# Autodesk Inventor assembly: MM0948AN160_G15_001
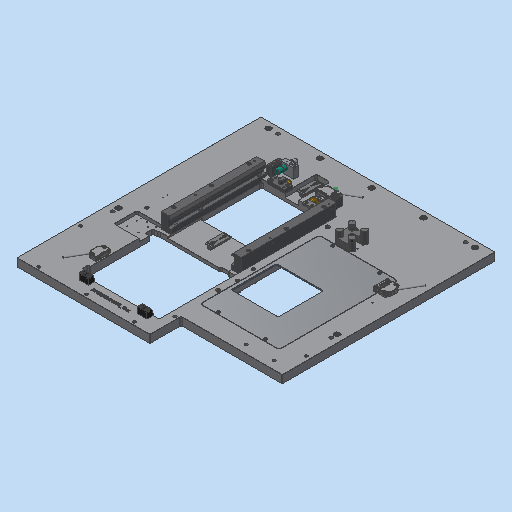
[picture p0: Inventor's stored thumbnail of the model, 512x512]
Saved by Autodesk Inventor 2023.3 (Build 273359000, 359)
## iProperties
Part Number: MM0948AN160_G15_001
Material: Generisch
Description: =<RBPARTNOTITLE2>
Document SubType Name: Assembly
Designer: FH/Wi
Mass: 74112.6 g
Surface Area: 13767 cm^2
Volume: 10091.6 cm^3
Density: 7.34398 g/cm^3
Created: 2023-03-23
RBCHANGEDESCRIPTION1: Erstfreigabe
RBCHANGENO1: 00
RBDOCUMENTTYPE: DRF
RBDOCUMENTVERSION: 00
RBDRAWINGMAINSCALE: 1:1
RBDRAWINGMISSINGSPEC: --
RBDRAWINGVOLUME: --
RBDSV1: 0850
RBGBDETAILS: 43274
RBGBEDGESIN1: +0,5
RBGBEDGESIN2: +0,2
RBGBEDGESOUT1: -0,3
RBGBEDGESOUT2: -0,1
RBMATERIAL: =<Material>
RBMATMEETS: --
RBMATNO: =<Part Number>
RBORGUNITRESPONSIBLE1: AnP/TEF1
RBPARTMADEOF: --
RBPARTNO: SIEHE MNR
RBPARTNOTITLE1: process plate CIPG
RBPARTNOTITLE2: Prozessplatte CIPG
RBPARTSAFETYINDICATOR: --
RBSURFACE: --
RBSURFACE2: --
RBZEDGESNORM: ISO13715:2002-06
RBZGENDIMCLASS: m
RBZGENDIMNORM: ISO 2768-1:1989-11
RBZGENGEOCLASS: H
RBZGENGEONORM: ISO 2768-2:1989-11
RBZSURFACENORM: ISO13D2:2002-02
RBZTOLERANCENORM: ISO 14405-1:2010-12
AnP_Kommentar: --
MaxAbmaße: --
AnP_TemplVers: 20190222
AnP_Kategorie: 99
AnP_Material: =<Material>
Author: FH/Wi
Keywords: =<RBPARTMADEOF>
Comments: =<RBSURFACE2>
Revision Number: 01
## Documents named in this file (51)
- C:\Users\rea9an\Documents\Inventor\TCAI2412_te1910_EM\AS00000961.iam
- C:\Users\rea9an\Documents\Inventor\TCAI2412_te1910_EM\PT00004403.ipt
- C:\Users\rea9an\Documents\Inventor\TCAI2412_te1910_EM\PT00004874.ipt
- C:\Users\rea9an\Documents\Inventor\TCAI2412_te1910_EM\PT00004872.ipt
- C:\Users\rea9an\Documents\Inventor\TCAI2412_te1910_EM\PT00004525.ipt
- C:\Users\rea9an\Documents\Inventor\TCAI2412_te1910_EM\PT00004526.ipt
- C:\Users\rea9an\Documents\Inventor\TCAI2412_te1910_EM\PT00004921.ipt
- C:\Users\rea9an\Documents\Inventor\TCAI2412_te1910_EM\PT00004871.ipt
- C:\Users\rea9an\Documents\Inventor\TCAI2412_te1910_EM\PT00004847.ipt
- C:\Users\rea9an\Documents\Inventor\TCAI2412_te1910_EM\PT00004900.ipt
- C:\Users\rea9an\Documents\Inventor\TCAI2412_te1910_EM\PT00004878.ipt
- C:\Users\rea9an\Documents\Inventor\TCAI2412_te1910_EM\PT00004778.ipt
- C:\Users\rea9an\Documents\Inventor\TCAI2412_te1910_EM\PT00004395.ipt
- C:\Users\rea9an\Documents\Inventor\TCAI2412_te1910_EM\PT00004876.ipt
- C:\Users\rea9an\Documents\Inventor\TCAI2412_te1910_EM\PT00004687.ipt
- C:\Users\rea9an\Documents\Inventor\TCAI2412_te1910_EM\PT00004692.ipt
- C:\Users\rea9an\Documents\Inventor\TCAI2412_te1910_EM\PT00004688.ipt
- C:\Users\rea9an\Documents\Inventor\TCAI2412_te1910_EM\PT00004883.ipt
- C:\Users\rea9an\Documents\Inventor\TCAI2412_te1910_EM\PT00004693.ipt
- C:\Users\rea9an\Documents\Inventor\TCAI2412_te1910_EM\PT00004869.ipt
- C:\Users\rea9an\Documents\Inventor\TCAI2412_te1910_EM\PT00004695.ipt
- C:\Users\rea9an\Documents\Inventor\TCAI2412_te1910_EM\PT00004689.ipt
- C:\Users\rea9an\Documents\Inventor\TCAI2412_te1910_EM\PT00004694.ipt
- C:\Users\rea9an\Documents\Inventor\TCAI2412_te1910_EM\PT00004691.ipt
- C:\Users\rea9an\Documents\Inventor\TCAI2412_te1910_EM\PT00004873.ipt
- C:\Users\rea9an\Documents\Inventor\TCAI2412_te1910_EM\PT00004690.ipt
- C:\Users\rea9an\Documents\Inventor\TCAI2412_te1910_EM\PT00004918.ipt
- C:\Users\rea9an\Documents\Inventor\TCAI2412_te1910_EM\PT00004846.ipt
- C:\Users\rea9an\Documents\Inventor\TCAI2412_te1910_EM\PT00004882.ipt
- C:\Users\rea9an\Documents\Inventor\TCAI2412_te1910_EM\PT00004889.ipt
- C:\Users\rea9an\Documents\Inventor\TCAI2412_te1910_EM\PT00004296.ipt
- C:\Users\rea9an\Documents\Inventor\TCAI2412_te1910_EM\PT00004315.ipt
- C:\Users\rea9an\Documents\Inventor\TCAI2412_te1910_EM\PT00004304.ipt
- C:\Users\rea9an\Documents\Inventor\TCAI2412_te1910_EM\PT00004696.ipt
- C:\Users\rea9an\Documents\Inventor\TCAI2412_te1910_EM\PT00004906.ipt
- C:\Users\rea9an\Documents\Inventor\TCAI2412_te1910_EM\PT00004908.ipt
- C:\Users\rea9an\Documents\Inventor\TCAI2412_te1910_EM\PT00004393.ipt
- C:\Users\rea9an\Documents\Inventor\TCAI2412_te1910_EM\PT00004907.ipt
- C:\Users\rea9an\Documents\Inventor\TCAI2412_te1910_EM\PT00004788.ipt
- C:\Users\rea9an\Documents\Inventor\TCAI2412_te1910_EM\PT00004398.ipt
- C:\Users\rea9an\Documents\Inventor\TCAI2412_te1910_EM\PT00004867.ipt
- C:\Users\rea9an\Documents\Inventor\TCAI2412_te1910_EM\PT00004400.ipt
- C:\Users\rea9an\Documents\Inventor\TCAI2412_te1910_EM\PT00004697.ipt
- C:\Users\rea9an\Documents\Inventor\TCAI2412_te1910_EM\PT00004830.ipt
- C:\Users\rea9an\Documents\Inventor\TCAI2412_te1910_EM\PT00004866.ipt
- C:\Users\rea9an\Documents\Inventor\TCAI2412_te1910_EM\PT00004915.ipt
- C:\Users\rea9an\Documents\Inventor\TCAI2412_te1910_EM\PT00004698.ipt
- C:\Users\rea9an\Documents\Inventor\TCAI2412_te1910_EM\PT00004699.ipt
- C:\Users\rea9an\Documents\Inventor\TCAI2412_te1910_EM\PT00004700.ipt
- C:\Users\rea9an\Documents\Inventor\TCAI2412_te1910_EM\PT00004892.ipt
- C:\Users\rea9an\Documents\Inventor\TCAI2412_te1910_EM\PT00004493.ipt
## Components (148 placed, 50 different names)
1. PT00004698:1 — Fluchtend:4, Fluchtend:5, Passend:18, Passend:19, Passend:20, Passend:22, Einfügen:29, Einfügen:30, Einfügen:36, Einfügen:37, Einfügen:76, Einfügen:77, Einfügen:78, Einfügen:79, Einfügen:80, Einfügen:81, Einfügen:84, Einfügen:86, Einfügen:93, Einfügen:94, Einfügen:95, Einfügen:96, Einfügen:97, Einfügen:98, Einfügen:99, Einfügen:100, Einfügen:101, Einfügen:102, Einfügen:103, Passend:54, Passend:56, Passend:57, Passend:58, Einfügen:109, Passend:60, Fluchtend:20, Passend:63, Passend:64, Passend:66, Passend:67, Passend:68, Passend:69, Passend:70, Passend:71, Passend:72, Passend:73, Passend:74, Passend:111, Fluchtend:21, Einfügen:122, Einfügen:123, Passend:115, Einfügen:136, Einfügen:137, Passend:121, Einfügen:153, Einfügen:154, Einfügen:155, Einfügen:156, Einfügen:157, Einfügen:158, Einfügen:159, Einfügen:160, Einfügen:161, Einfügen:162, Einfügen:163, Einfügen:164, Einfügen:165, Einfügen:166, Einfügen:167, Einfügen:179, Einfügen:180, Einfügen:194, Einfügen:195, Einfügen:197, Winkel:1, Einfügen:198, Einfügen:199, Einfügen:200, Passend:137, Passend:138, Einfügen:203, Einfügen:204, Passend:143, Fluchtend:45, Passend:146, Einfügen:207, Einfügen:208, Einfügen:209, Einfügen:210
2. PT00004687:1 — Passend:115, Einfügen:136, Einfügen:137, Passend:144, Fluchtend:46, Passend:145
3. PT00004699:1 — Fluchtend:3, Fluchtend:4, Passend:18, Passend:44, Passend:45, Fluchtend:12, Fluchtend:13, Einfügen:183, Einfügen:184, Einfügen:185, Einfügen:186, Einfügen:203
4. PT00004700:1 — Fluchtend:3, Fluchtend:5, Passend:19, Passend:36, Passend:43, Fluchtend:14, Fluchtend:15, Einfügen:187, Einfügen:188, Einfügen:189, Einfügen:190
5. PT00004688:1 — Passend:20, Einfügen:81, Fluchtend:23
6. PT00004688:2 — Passend:22, Einfügen:80, Fluchtend:22
7. PT00004689:2 — Einfügen:29, Einfügen:30
8. PT00004690:1 — Passend:121, Fluchtend:27, Fluchtend:29, Fluchtend:30, Einfügen:145, Einfügen:146, Einfügen:149, Einfügen:150, Einfügen:153
9. PT00004690:2 — Fluchtend:29, Fluchtend:30, Einfügen:143, Einfügen:144, Einfügen:147, Einfügen:148, Einfügen:204
10. PT00004691:1 — Passend:36, Fluchtend:14
11. PT00004691:2 — Passend:43, Fluchtend:15
12. PT00004691:3 — Passend:44, Fluchtend:13
13. PT00004691:4 — Passend:45, Fluchtend:12
14. PT00004692:1 — Passend:54, Passend:56, Passend:57, Einfügen:107, Einfügen:108, Passend:116, Passend:117, Passend:151, Passend:152, Fluchtend:54, Passend:155
15. PT00004693:1 — Passend:58, Passend:59, Einfügen:109, Passend:60
16. PT00004694:1 — Einfügen:36, Passend:124
17. PT00004694:2 — Einfügen:37, Passend:124
18. PT00004695:1 — Fluchtend:20, Passend:63, Passend:64, Passend:95, Passend:96
19. PT00004695:2 — Passend:66, Passend:67, Passend:68, Passend:103, Passend:104
20. PT00004695:3 — Passend:69, Passend:73, Passend:74, Passend:93, Passend:94
21. PT00004695:4 — Passend:70, Passend:71, Passend:72, Passend:105, Passend:106
22. PT00004696:1 — Einfügen:194, Einfügen:195
23. PT00004788:1 — Einfügen:201, Einfügen:202, Passend:137, Passend:138
24. PT00004907:1 — Einfügen:199
25. PT00004907:2 — Einfügen:200
26. PT00004907:3 — Einfügen:198
27. PT00004871:15 — Einfügen:202
28. PT00004871:16 — Einfügen:201
29. PT00004395:4 — Passend:143, Fluchtend:45, Passend:146, Passend:147, Passend:148, Passend:149, Passend:150
30. PT00004398:2 — Passend:144, Fluchtend:46, Passend:145, Einfügen:205, Einfügen:206
31. PT00004867:1 — Passend:148, Passend:149
32. PT00004867:2 — Passend:147, Passend:150
33. PT00004867:3 — Einfügen:206
34. PT00004867:4 — Einfügen:205
35. PT00004697:1 — Passend:151, Passend:152, Passend:153, Fluchtend:52, Passend:156, Passend:157
36. PT00004400:2 — Passend:153, Fluchtend:52, Fluchtend:54, Passend:154, Passend:157
37. PT00004830:1 — Passend:154
38. PT00004866:1 — Passend:155, Passend:156
39. PT00004493:1 — Einfügen:210
40. PT00004493:2 — Einfügen:209
41. PT00004882:7 — Einfügen:197, Passend:132
42. PT00004878:6
43. PT00004878:5
44. PT00004393:9 — Einfügen:188
45. PT00004393:8 — Einfügen:187
46. PT00004393:6 — Einfügen:184
47. PT00004393:5 — Einfügen:185
48. PT00004393:4 — Einfügen:186
49. PT00004393:3 — Einfügen:189
50. PT00004393:2 — Einfügen:190
51. PT00004393:1 — Einfügen:183
52. PT00004908:1 — Einfügen:180
53. PT00004906:1 — Einfügen:179
54. PT00004889:2 — Einfügen:160
55. PT00004889:1 — Einfügen:159
56. PT00004882:6 — Einfügen:154
57. PT00004882:5 — Einfügen:155
58. PT00004882:4 — Einfügen:156
59. PT00004882:3 — Einfügen:157
60. PT00004882:2 — Einfügen:158
61. PT00004846:4 — Einfügen:150
62. PT00004846:3 — Einfügen:149
63. PT00004846:2 — Einfügen:148
64. PT00004846:1 — Einfügen:147
65. PT00004918:4 — Einfügen:146
66. PT00004918:3 — Einfügen:145
67. PT00004918:2 — Einfügen:144
68. PT00004918:1 — Einfügen:143
69. PT00004876:1
70. PT00004876:2
71. PT00004876:3
72. PT00004876:4
73. PT00004892:3
74. PT00004892:1
75. PT00004892:2
76. PT00004892:4
77. PT00004892:5
78. PT00004892:6
79. PT00004874:4
80. PT00004874:3
81. PT00004915:1 — Einfügen:208
82. PT00004921:2 — Einfügen:84
83. PT00004915:2 — Einfügen:207
84. PT00004921:4 — Einfügen:86
85. PT00004883:1
86. PT00004883:2
87. PT00004883:3
88. PT00004883:4
89. PT00004871:1 — Einfügen:123
90. PT00004871:2 — Einfügen:122, Passend:112
91. PT00004847:1 — Einfügen:93
92. PT00004847:2 — Einfügen:94
93. PT00004847:3 — Einfügen:95
94. PT00004847:4 — Einfügen:96
95. PT00004847:5 — Einfügen:97
96. PT00004847:6 — Einfügen:99
97. PT00004847:7 — Einfügen:98
98. PT00004900:1 — Einfügen:100
99. PT00004900:2 — Einfügen:101
100. PT00004900:3 — Einfügen:102
101. PT00004900:4 — Einfügen:103
102. PT00004869:1
103. PT00004869:2
104. PT00004872:1 — Einfügen:107
105. PT00004872:2 — Einfügen:108
106. PT00004873:2
107. PT00004873:1
108. PT00004871:7
109. PT00004871:8
110. PT00004871:13
111. PT00004871:14
112. PT00004871:9
113. PT00004871:10
114. PT00004871:12
115. PT00004871:11
116. PT00004778:7 — Passend:94
117. PT00004778:2 — Passend:96
118. PT00004778:3 — Passend:103
119. PT00004778:5 — Passend:106
120. PT00004778:1 — Passend:95
121. PT00004778:8 — Passend:93
122. PT00004778:4 — Passend:104
123. PT00004778:6 — Passend:105
124. PT00004296:6
125. PT00004315:6 — Passend:132, Fluchtend:43, Winkel:1
126. PT00004296:1 — Passend:125, Fluchtend:31, Fluchtend:32
127. PT00004315:1 — Passend:125, Fluchtend:31, Fluchtend:32, Einfügen:161
128. PT00004296:2
129. PT00004315:2 — Einfügen:163
130. PT00004296:3
131. PT00004315:3 — Einfügen:164
132. PT00004296:4
133. PT00004315:4 — Einfügen:162
134. PT00004296:5
135. PT00004315:5 — Einfügen:165, Fluchtend:43
136. PT00004304:1 — Einfügen:167
137. PT00004304:2 — Einfügen:166
138. PT00004526:1
139. PT00004525:1 — Einfügen:76
140. PT00004526:2
141. PT00004525:2 — Einfügen:77
142. PT00004525:3 — Einfügen:78
143. PT00004525:4 — Einfügen:79
144. PT00004526:3
145. PT00004526:4
146. PT00004403:1 — Passend:59, Fluchtend:22
147. PT00004395:1 — Passend:111, Fluchtend:21, Passend:112
148. PT00004395:2 — Fluchtend:23, Passend:116, Passend:117
## Relationships (230: Insert 101, Mate 97, Flush 31, Angle 1)
- Fluchtend:3 [Flush]: PT00004699:1 ↔ PT00004700:1
- Fluchtend:4 [Flush]: PT00004698:1 ↔ PT00004699:1
- Fluchtend:5 [Flush]: PT00004698:1 ↔ PT00004700:1
- [Insert]: PT00004699:1 ↔ PT00004892:2
- [Insert]: PT00004699:1 ↔ PT00004892:1
- [Insert]: PT00004699:1 ↔ PT00004892:3
- [Insert]: PT00004700:1 ↔ PT00004892:4
- [Insert]: PT00004700:1 ↔ PT00004892:5
- [Insert]: PT00004700:1 ↔ PT00004892:6
- Passend:18 [Mate]: PT00004698:1 ↔ PT00004699:1
- Passend:19 [Mate]: PT00004698:1 ↔ PT00004700:1
- Passend:20 [Mate]: PT00004698:1 ↔ PT00004688:1
- Passend:22 [Mate]: PT00004698:1 ↔ PT00004688:2
- [Insert]: PT00004689:2 ↔ PT00004874:4
- [Insert]: PT00004689:2 ↔ PT00004874:3
- Einfügen:29 [Insert]: PT00004698:1 ↔ PT00004689:2
- Einfügen:30 [Insert]: PT00004698:1 ↔ PT00004689:2
- Einfügen:36 [Insert]: PT00004698:1 ↔ PT00004694:1
- Einfügen:37 [Insert]: PT00004698:1 ↔ PT00004694:2
- [Mate]: PT00004691:1 ↔ PT00004526:1
- [Mate] (0.4 mm): PT00004691:1 ↔ PT00004526:1
- Passend:36 [Mate]: PT00004700:1 ↔ PT00004691:1
- [Mate]: PT00004691:2 ↔ PT00004526:2
- [Mate] (0.4 mm): PT00004691:2 ↔ PT00004526:2
- [Mate]: PT00004691:3 ↔ PT00004526:3
- [Mate] (0.4 mm): PT00004691:3 ↔ PT00004526:3
- [Mate]: PT00004691:4 ↔ PT00004526:4
- [Mate] (0.4 mm): PT00004691:4 ↔ PT00004526:4
- Passend:43 [Mate]: PT00004700:1 ↔ PT00004691:2
- Passend:44 [Mate]: PT00004699:1 ↔ PT00004691:3
- Passend:45 [Mate]: PT00004699:1 ↔ PT00004691:4
- Fluchtend:12 [Flush]: PT00004699:1 ↔ PT00004691:4
- Fluchtend:13 [Flush]: PT00004699:1 ↔ PT00004691:3
- Fluchtend:14 [Flush]: PT00004700:1 ↔ PT00004691:1
- Fluchtend:15 [Flush]: PT00004700:1 ↔ PT00004691:2
- Einfügen:76 [Insert]: PT00004698:1 ↔ PT00004525:1
- Einfügen:77 [Insert]: PT00004698:1 ↔ PT00004525:2
- Einfügen:78 [Insert]: PT00004698:1 ↔ PT00004525:3
- Einfügen:79 [Insert]: PT00004698:1 ↔ PT00004525:4
- Einfügen:80 [Insert]: PT00004698:1 ↔ PT00004688:2
- Einfügen:81 [Insert]: PT00004698:1 ↔ PT00004688:1
- Einfügen:84 [Insert] (-1 mm): PT00004698:1 ↔ PT00004921:2
- Einfügen:86 [Insert] (-1 mm): PT00004698:1 ↔ PT00004921:4
- [Insert]: PT00004688:1 ↔ PT00004883:3
- [Insert]: PT00004688:1 ↔ PT00004883:4
- [Insert]: PT00004688:2 ↔ PT00004883:1
- [Insert]: PT00004688:2 ↔ PT00004883:2
- Einfügen:93 [Insert]: PT00004698:1 ↔ PT00004847:1
- Einfügen:94 [Insert]: PT00004698:1 ↔ PT00004847:2
- Einfügen:95 [Insert]: PT00004698:1 ↔ PT00004847:3
- Einfügen:96 [Insert]: PT00004698:1 ↔ PT00004847:4
- Einfügen:97 [Insert]: PT00004698:1 ↔ PT00004847:5
- Einfügen:98 [Insert]: PT00004698:1 ↔ PT00004847:7
- Einfügen:99 [Insert]: PT00004698:1 ↔ PT00004847:6
- Einfügen:100 [Insert]: PT00004698:1 ↔ PT00004900:1
- Einfügen:101 [Insert]: PT00004698:1 ↔ PT00004900:2
- Einfügen:102 [Insert]: PT00004698:1 ↔ PT00004900:3
- Einfügen:103 [Insert]: PT00004698:1 ↔ PT00004900:4
- Passend:54 [Mate]: PT00004698:1 ↔ PT00004692:1
- Passend:56 [Mate]: PT00004698:1 ↔ PT00004692:1
- Passend:57 [Mate]: PT00004698:1 ↔ PT00004692:1
- Einfügen:107 [Insert]: PT00004692:1 ↔ PT00004872:1
- Einfügen:108 [Insert]: PT00004692:1 ↔ PT00004872:2
- Passend:58 [Mate]: PT00004698:1 ↔ PT00004693:1
- Passend:59 [Mate]: PT00004693:1 ↔ PT00004403:1
- Einfügen:109 [Insert]: PT00004698:1 ↔ PT00004693:1
- Passend:60 [Mate]: PT00004698:1 ↔ PT00004693:1
- [Insert]: PT00004693:1 ↔ PT00004873:2
- [Insert]: PT00004693:1 ↔ PT00004873:1
- Fluchtend:20 [Flush]: PT00004698:1 ↔ PT00004695:1
- Passend:63 [Mate]: PT00004698:1 ↔ PT00004695:1
- Passend:64 [Mate]: PT00004698:1 ↔ PT00004695:1
- Passend:66 [Mate]: PT00004698:1 ↔ PT00004695:2
- Passend:67 [Mate]: PT00004698:1 ↔ PT00004695:2
- Passend:68 [Mate]: PT00004698:1 ↔ PT00004695:2
- Passend:69 [Mate]: PT00004698:1 ↔ PT00004695:3
- Passend:70 [Mate]: PT00004698:1 ↔ PT00004695:4
- Passend:71 [Mate]: PT00004698:1 ↔ PT00004695:4
- Passend:72 [Mate]: PT00004698:1 ↔ PT00004695:4
- Passend:73 [Mate]: PT00004698:1 ↔ PT00004695:3
- Passend:74 [Mate]: PT00004698:1 ↔ PT00004695:3
- [Mate]: PT00004695:1 ↔ PT00004871:7
- [Mate]: PT00004695:1 ↔ PT00004871:8
- [Mate]: PT00004695:3 ↔ PT00004871:9
- [Mate]: PT00004695:3 ↔ PT00004871:10
- [Mate]: PT00004871:7 ↔ PT00004778:1
- [Mate]: PT00004871:8 ↔ PT00004778:2
- [Mate]: PT00004695:2 ↔ PT00004871:13
- [Mate]: PT00004695:2 ↔ PT00004871:14
- [Mate]: PT00004695:4 ↔ PT00004871:12
- [Mate]: PT00004695:4 ↔ PT00004871:11
- [Mate]: PT00004695:1 ↔ PT00004778:2
- [Mate]: PT00004695:1 ↔ PT00004778:1
- [Mate]: PT00004695:3 ↔ PT00004778:8
- [Mate]: PT00004695:3 ↔ PT00004778:7
- Passend:93 [Mate]: PT00004695:3 ↔ PT00004778:8
- Passend:94 [Mate]: PT00004695:3 ↔ PT00004778:7
- Passend:95 [Mate]: PT00004695:1 ↔ PT00004778:1
- Passend:96 [Mate]: PT00004695:1 ↔ PT00004778:2
- [Mate]: PT00004871:9 ↔ PT00004778:8
- [Mate]: PT00004871:10 ↔ PT00004778:7
- [Mate]: PT00004695:2 ↔ PT00004778:3
- [Mate]: PT00004695:2 ↔ PT00004778:4
- [Mate]: PT00004695:4 ↔ PT00004778:6
- [Mate]: PT00004695:4 ↔ PT00004778:5
- Passend:103 [Mate]: PT00004695:2 ↔ PT00004778:3
- Passend:104 [Mate]: PT00004695:2 ↔ PT00004778:4
- Passend:105 [Mate]: PT00004695:4 ↔ PT00004778:6
- Passend:106 [Mate]: PT00004695:4 ↔ PT00004778:5
- [Mate]: PT00004871:13 ↔ PT00004778:3
- [Mate]: PT00004871:14 ↔ PT00004778:4
- [Mate]: PT00004871:12 ↔ PT00004778:6
- [Mate]: PT00004871:11 ↔ PT00004778:5
- Passend:111 [Mate]: PT00004698:1 ↔ PT00004395:1
- Fluchtend:21 [Flush] (-3.2 mm): PT00004698:1 ↔ PT00004395:1
- Einfügen:122 [Insert] (7.6 mm): PT00004698:1 ↔ PT00004871:2
- Einfügen:123 [Insert] (7.6 mm): PT00004698:1 ↔ PT00004871:1
- Passend:112 [Mate] (2.1 mm): PT00004871:2 ↔ PT00004395:1
- [Insert]: PT00004687:1 ↔ PT00004876:1
- [Insert]: PT00004687:1 ↔ PT00004876:2
- [Insert]: PT00004687:1 ↔ PT00004876:4
- [Insert]: PT00004687:1 ↔ PT00004876:3
- Passend:115 [Mate]: PT00004698:1 ↔ PT00004687:1
- Einfügen:136 [Insert]: PT00004698:1 ↔ PT00004687:1
- Einfügen:137 [Insert]: PT00004698:1 ↔ PT00004687:1
- Fluchtend:22 [Flush] (-3 mm): PT00004688:2 ↔ PT00004403:1
- Fluchtend:23 [Flush] (10 mm): PT00004688:1 ↔ PT00004395:2
- [Insert] (7.6 mm): PT00004692:1 ↔ PT00004869:2
- [Insert] (7.6 mm): PT00004692:1 ↔ PT00004869:1
- Passend:116 [Mate]: PT00004692:1 ↔ PT00004395:2
- Passend:117 [Mate]: PT00004692:1 ↔ PT00004395:2
- Passend:121 [Mate]: PT00004698:1 ↔ PT00004690:1
- Fluchtend:27 [Flush] (105 mm): PT00004690:1
- Fluchtend:29 [Flush]: PT00004690:1 ↔ PT00004690:2
- Fluchtend:30 [Flush]: PT00004690:1 ↔ PT00004690:2
- Einfügen:143 [Insert]: PT00004690:2 ↔ PT00004918:1
- Einfügen:144 [Insert]: PT00004690:2 ↔ PT00004918:2
- Einfügen:145 [Insert]: PT00004690:1 ↔ PT00004918:3
- Einfügen:146 [Insert]: PT00004690:1 ↔ PT00004918:4
- Einfügen:147 [Insert]: PT00004690:2 ↔ PT00004846:1
- Einfügen:148 [Insert]: PT00004690:2 ↔ PT00004846:2
- Einfügen:149 [Insert]: PT00004690:1 ↔ PT00004846:3
- Einfügen:150 [Insert]: PT00004690:1 ↔ PT00004846:4
- Passend:124 [Mate]: PT00004694:1 ↔ PT00004694:2
- Einfügen:153 [Insert]: PT00004698:1 ↔ PT00004690:1
- Einfügen:154 [Insert]: PT00004698:1 ↔ PT00004882:6
- Einfügen:155 [Insert]: PT00004698:1 ↔ PT00004882:5
- Einfügen:156 [Insert]: PT00004698:1 ↔ PT00004882:4
- Einfügen:157 [Insert]: PT00004698:1 ↔ PT00004882:3
- Einfügen:158 [Insert]: PT00004698:1 ↔ PT00004882:2
- Einfügen:159 [Insert]: PT00004698:1 ↔ PT00004889:1
- Einfügen:160 [Insert]: PT00004698:1 ↔ PT00004889:2
- Passend:125 [Mate]: PT00004296:1 ↔ PT00004315:1
- Fluchtend:31 [Flush]: PT00004296:1 ↔ PT00004315:1
- Fluchtend:32 [Flush]: PT00004296:1 ↔ PT00004315:1
- Einfügen:161 [Insert] (1.5 mm): PT00004698:1 ↔ PT00004315:1
- [Mate]: PT00004296:2 ↔ PT00004315:2
- [Flush]: PT00004296:2 ↔ PT00004315:2
- [Flush]: PT00004296:2 ↔ PT00004315:2
- [Mate]: PT00004296:3 ↔ PT00004315:3
- [Flush]: PT00004296:3 ↔ PT00004315:3
- [Flush]: PT00004296:3 ↔ PT00004315:3
- [Mate]: PT00004296:4 ↔ PT00004315:4
- [Flush]: PT00004296:4 ↔ PT00004315:4
- [Flush]: PT00004296:4 ↔ PT00004315:4
- [Mate]: PT00004296:5 ↔ PT00004315:5
- [Flush]: PT00004296:5 ↔ PT00004315:5
- [Flush]: PT00004296:5 ↔ PT00004315:5
- Einfügen:162 [Insert] (1.5 mm): PT00004698:1 ↔ PT00004315:4
- Einfügen:163 [Insert] (1.5 mm): PT00004698:1 ↔ PT00004315:2
- Einfügen:164 [Insert] (1.5 mm): PT00004698:1 ↔ PT00004315:3
- Einfügen:165 [Insert] (1.5 mm): PT00004698:1 ↔ PT00004315:5
- Einfügen:166 [Insert] (2 mm): PT00004698:1 ↔ PT00004304:2
- Einfügen:167 [Insert] (2 mm): PT00004698:1 ↔ PT00004304:1
- Einfügen:179 [Insert]: PT00004698:1 ↔ PT00004906:1
- Einfügen:180 [Insert]: PT00004698:1 ↔ PT00004908:1
- Einfügen:183 [Insert]: PT00004699:1 ↔ PT00004393:1
- Einfügen:184 [Insert]: PT00004699:1 ↔ PT00004393:6
- Einfügen:185 [Insert]: PT00004699:1 ↔ PT00004393:5
- Einfügen:186 [Insert]: PT00004699:1 ↔ PT00004393:4
- Einfügen:187 [Insert]: PT00004700:1 ↔ PT00004393:8
- Einfügen:188 [Insert]: PT00004700:1 ↔ PT00004393:9
- Einfügen:189 [Insert]: PT00004700:1 ↔ PT00004393:3
- Einfügen:190 [Insert]: PT00004700:1 ↔ PT00004393:2
- [Insert]: PT00004696:1 ↔ PT00004878:5
- [Insert]: PT00004696:1 ↔ PT00004878:6
- Einfügen:194 [Insert]: PT00004698:1 ↔ PT00004696:1
- Einfügen:195 [Insert]: PT00004698:1 ↔ PT00004696:1
- [Mate]: PT00004296:6 ↔ PT00004315:6
- [Flush]: PT00004296:6 ↔ PT00004315:6
- [Flush]: PT00004296:6 ↔ PT00004315:6
- Einfügen:197 [Insert]: PT00004698:1 ↔ PT00004882:7
- Passend:132 [Mate]: PT00004882:7 ↔ PT00004315:6
- Fluchtend:43 [Flush]: PT00004315:6 ↔ PT00004315:5
- Winkel:1 [Angle] (0 deg): PT00004698:1 ↔ PT00004315:6
- [Mate]: PT00004698:1 ↔ PT00004788:1
- Einfügen:198 [Insert] (1 mm): PT00004698:1 ↔ PT00004907:3
- Einfügen:199 [Insert] (1 mm): PT00004698:1 ↔ PT00004907:1
- Einfügen:200 [Insert] (1 mm): PT00004698:1 ↔ PT00004907:2
- Einfügen:201 [Insert]: PT00004788:1 ↔ PT00004871:16
- Einfügen:202 [Insert]: PT00004788:1 ↔ PT00004871:15
- Passend:137 [Mate]: PT00004698:1 ↔ PT00004788:1
- Passend:138 [Mate]: PT00004698:1 ↔ PT00004788:1
- Einfügen:203 [Insert]: PT00004698:1 ↔ PT00004699:1
- Einfügen:204 [Insert]: PT00004698:1 ↔ PT00004690:2
- Passend:143 [Mate]: PT00004698:1 ↔ PT00004395:4
- Fluchtend:45 [Flush] (2 mm): PT00004698:1 ↔ PT00004395:4
- Passend:144 [Mate]: PT00004687:1 ↔ PT00004398:2
- Fluchtend:46 [Flush] (2 mm): PT00004687:1 ↔ PT00004398:2
- Passend:145 [Mate]: PT00004687:1 ↔ PT00004398:2
- Passend:146 [Mate]: PT00004698:1 ↔ PT00004395:4
- Einfügen:205 [Insert]: PT00004398:2 ↔ PT00004867:4
- Einfügen:206 [Insert]: PT00004398:2 ↔ PT00004867:3
- Passend:147 [Mate]: PT00004395:4 ↔ PT00004867:2
- Passend:148 [Mate]: PT00004395:4 ↔ PT00004867:1
- Passend:149 [Mate]: PT00004395:4 ↔ PT00004867:1
- Passend:150 [Mate]: PT00004395:4 ↔ PT00004867:2
- Passend:151 [Mate]: PT00004692:1 ↔ PT00004697:1
- Passend:152 [Mate]: PT00004692:1 ↔ PT00004697:1
- Passend:153 [Mate]: PT00004697:1 ↔ PT00004400:2
- Fluchtend:52 [Flush]: PT00004697:1 ↔ PT00004400:2
- Fluchtend:54 [Flush] (-11 mm): PT00004692:1 ↔ PT00004400:2
- Passend:154 [Mate]: PT00004400:2 ↔ PT00004830:1
- Passend:155 [Mate]: PT00004692:1 ↔ PT00004866:1
- Passend:156 [Mate]: PT00004697:1 ↔ PT00004866:1
- Passend:157 [Mate]: PT00004697:1 ↔ PT00004400:2
- Einfügen:207 [Insert] (-1 mm): PT00004698:1 ↔ PT00004915:2
- Einfügen:208 [Insert] (-1 mm): PT00004698:1 ↔ PT00004915:1
- Einfügen:209 [Insert]: PT00004698:1 ↔ PT00004493:2
- Einfügen:210 [Insert]: PT00004698:1 ↔ PT00004493:1
## Named parameters: d68_d533 = 0 mm, d69_d471 = 0 mm, d157_d340 = 0 mm, d158_d342 = 0.4 mm, d159_d340 = 0 mm, d160_d342 = 0.4 mm, d161_d340 = 0 mm, d162_d342 = 0.4 mm, d310_d315 = 0 mm, d311_d316 = 0 mm, d312_d317 = 0 mm, d395_d391 = 0 mm, d396_d392 = 0 mm, d397_d393 = 0 mm, d398_d391 = 0 mm, d399_d392 = 0 mm, d400_d393 = 0 mm, d401_d391 = 0 mm, d402_d392 = 0 mm, d403_d393 = 0 mm, d404_d391 = 0 mm, d405_d392 = 0 mm, d406_d393 = 0 mm, d459_d449 = 0 mm, d460_d450 = 0 mm, d465_d398_d391 = 0 mm, d466_d399_d392 = 0 mm, d467_d400_d393 = 0 mm
